# Autodesk Inventor assembly: Einspannvorrichtung
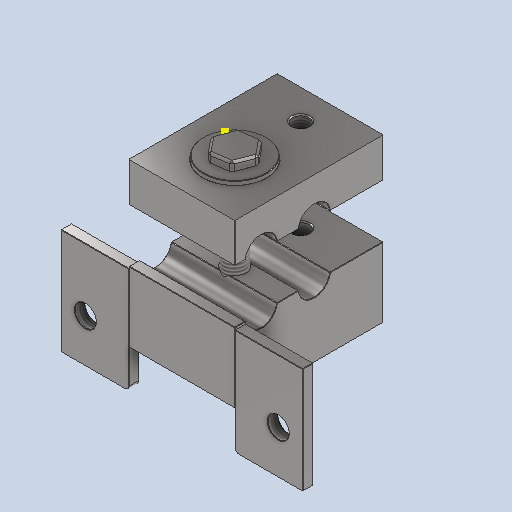
[picture p0: Inventor's stored thumbnail of the model, 512x512]
Saved by Autodesk Inventor 2026.2 (Build 302298010, 298A)
## iProperties
Created: 2026-07-28
Part Number: Einspannvorrichtung
Document SubType Name: Weldment
Designer: moest
Weld Material: Welded Aluminum-6061
Author: moest
## Documents named in this file (7)
- C:\Users\moest\Downloads\Einspannvorrichtung.iam
- C:\Users\moest\Downloads\Einspannvorrichtung Beilagscheibe.ipt
- C:\Users\moest\Downloads\Einspannvorrichtung Nebenbacke.ipt
- C:\Users\moest\Downloads\Einspannvorrichtung Hauptbacke.ipt
- C:\Users\moest\Downloads\EInspannvorrichtung Befestigunsplatte.ipt
- C:\Users\moest\Downloads\Einspannvorrichtung Bolzenschraube.ipt
- C:\Users\moest\Documents\Inventor\Content Center Files\R2026\de-DE\AS 1112 (2)\AS 1112 - M10  Typ 5.ipt
## Components (7 placed, 6 different names)
1. Einspannvorrichtung Beilagscheibe:1 — Passend:1, Passend:2, Passend:3
2. Einspannvorrichtung Nebenbacke:1 — Passend:3, Passend:4, Fluchtend:1
3. Einspannvorrichtung Hauptbacke:1 — Passend:5, Fluchtend:1, Passend:6, Fluchtend:8, Fluchtend:9, Passend:7, Fluchtend:10, Fluchtend:11, Passend:8, Passend:9
4. EInspannvorrichtung Befestigunsplatte:1 — Passend:6, Fluchtend:8, Fluchtend:9
5. Einspannvorrichtung Bolzenschraube:1 — Passend:1, Passend:2, Passend:4, Passend:5, Passend:10
6. EInspannvorrichtung Befestigunsplatte:2 — Passend:7, Fluchtend:10, Fluchtend:11
7. AS 1112 (2) - Metrisch M10  Typ 5:1 — Passend:8, Passend:9, Passend:10
## Relationships (15: Mate 10, Flush 5)
- Passend:1 [Mate]: Einspannvorrichtung Beilagscheibe:1 ↔ Einspannvorrichtung Bolzenschraube:1
- Passend:2 [Mate]: Einspannvorrichtung Beilagscheibe:1 ↔ Einspannvorrichtung Bolzenschraube:1
- Passend:3 [Mate]: Einspannvorrichtung Beilagscheibe:1 ↔ Einspannvorrichtung Nebenbacke:1
- Passend:4 [Mate]: Einspannvorrichtung Nebenbacke:1 ↔ Einspannvorrichtung Bolzenschraube:1
- Passend:5 [Mate]: Einspannvorrichtung Hauptbacke:1 ↔ Einspannvorrichtung Bolzenschraube:1
- Fluchtend:1 [Flush]: Einspannvorrichtung Nebenbacke:1 ↔ Einspannvorrichtung Hauptbacke:1
- Passend:6 [Mate]: Einspannvorrichtung Hauptbacke:1 ↔ EInspannvorrichtung Befestigunsplatte:1
- Fluchtend:8 [Flush]: Einspannvorrichtung Hauptbacke:1 ↔ EInspannvorrichtung Befestigunsplatte:1
- Fluchtend:9 [Flush] (1 mm): Einspannvorrichtung Hauptbacke:1 ↔ EInspannvorrichtung Befestigunsplatte:1
- Passend:7 [Mate]: Einspannvorrichtung Hauptbacke:1 ↔ EInspannvorrichtung Befestigunsplatte:2
- Fluchtend:10 [Flush] (1 mm): Einspannvorrichtung Hauptbacke:1 ↔ EInspannvorrichtung Befestigunsplatte:2
- Fluchtend:11 [Flush]: Einspannvorrichtung Hauptbacke:1 ↔ EInspannvorrichtung Befestigunsplatte:2
- Passend:8 [Mate]: Einspannvorrichtung Hauptbacke:1 ↔ AS 1112 (2) - Metrisch M10  Typ 5:1
- Passend:9 [Mate]: Einspannvorrichtung Hauptbacke:1 ↔ AS 1112 (2) - Metrisch M10  Typ 5:1
- Passend:10 [Mate]: Einspannvorrichtung Bolzenschraube:1 ↔ AS 1112 (2) - Metrisch M10  Typ 5:1
